# Autodesk Inventor assembly: MM0948AN100_G42_001
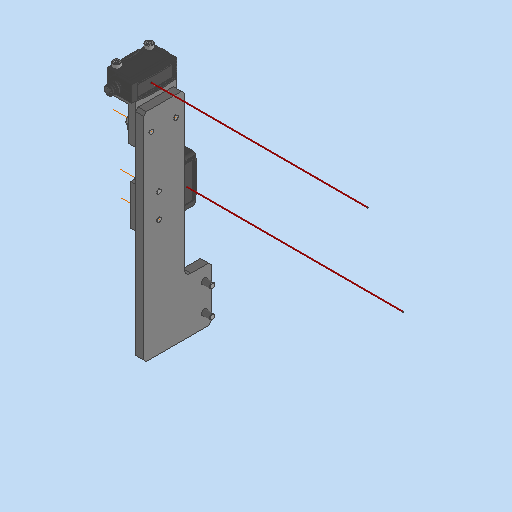
[picture p0: Inventor's stored thumbnail of the model, 512x512]
Saved by Autodesk Inventor 2023.3 (Build 273359000, 359)
## iProperties
Created: 2024-02-27
Part Number: MM0948AN100_G42_001
Description: =<RBPARTNOTITLE2>
Document SubType Name: Assembly
Designer: RIC7AN
Mass: 525.375 g
Surface Area: 330.007 cm^2
Volume: 64.7643 cm^3
Density: 8.11211 g/cm^3
RBPARTMADEOF: --
RBDRAWINGMISSINGSPEC: --
AnP_Kategorie: 99
RBPARTNOTITLE2: Sensorhalter
RBSURFACE: --
RBPARTNOTITLE1: sensor mount
AnP_Material: =<Material>
RBMATERIAL: =<Material>
RBMATNO: =<Part Number>
RBPARTNO: SIEHE MNR
Author: RIC7AN
Keywords: =<RBPARTMADEOF>
Comments: =<RBSURFACE2>
Revision Number: 01
## Documents named in this file (7)
- C:\Users\rea9an\Documents\Inventor\TCAI2412_te1910_EM\AS00000937.iam
- C:\Users\rea9an\Documents\Inventor\TCAI2412_te1910_EM\PT00004453.ipt
- C:\Users\rea9an\Documents\Inventor\TCAI2412_te1910_EM\PT00004626.ipt
- C:\Users\rea9an\Documents\Inventor\TCAI2412_te1910_EM\PT00004627.ipt
- C:\Users\rea9an\Documents\Inventor\TCAI2412_te1910_EM\PT00004867.ipt
- C:\Users\rea9an\Documents\Inventor\TCAI2412_te1910_EM\PT00004783.ipt
- C:\Users\rea9an\Documents\Inventor\TCAI2412_te1910_EM\PT00004859.ipt
## Components (19 placed, 6 different names)
1. PT00004453:1
2. PT00004626:1
3. PT00004627:1
4. PT00004627:2
5. PT00004453:2
6. PT00004867:1
7. PT00004783:1
8. PT00004867:2
9. PT00004783:2
10. PT00004867:3
11. PT00004783:3
12. PT00004867:4
13. PT00004783:4
14. PT00004867:5
15. PT00004867:6
16. PT00004859:1
17. PT00004859:2
18. PT00004859:3
19. PT00004859:4
## Relationships (30: Mate 18, Insert 9, Angle 2, Flush 1)
- [Mate]: PT00004626:1 ↔ PT00004627:1
- [Flush]: PT00004626:1 ↔ PT00004627:1
- [Mate]: PT00004453:1 ↔ PT00004627:1
- [Mate]: PT00004626:1 ↔ PT00004627:2
- [Mate]: PT00004453:1 ↔ PT00004627:1
- [Angle] (0 deg): PT00004453:1 ↔ PT00004627:1
- [Insert]: PT00004627:2 ↔ PT00004453:2
- [Angle] (0 deg): PT00004627:2 ↔ PT00004453:2
- [Mate]: PT00004626:1 ↔ PT00004627:2
- [Mate]: PT00004626:1 ↔ PT00004627:2
- [Insert]: PT00004867:1 ↔ PT00004783:1
- [Insert]: PT00004867:2 ↔ PT00004783:2
- [Insert]: PT00004867:3 ↔ PT00004783:3
- [Insert]: PT00004867:4 ↔ PT00004783:4
- [Mate]: PT00004627:1 ↔ PT00004867:1
- [Mate]: PT00004627:1 ↔ PT00004867:2
- [Mate]: PT00004627:2 ↔ PT00004867:3
- [Mate]: PT00004627:2 ↔ PT00004867:4
- [Mate]: PT00004627:1 ↔ PT00004783:1
- [Mate]: PT00004627:1 ↔ PT00004783:2
- [Mate]: PT00004627:2 ↔ PT00004783:3
- [Mate]: PT00004627:2 ↔ PT00004783:4
- [Insert]: PT00004626:1 ↔ PT00004867:5
- [Insert]: PT00004626:1 ↔ PT00004867:6
- [Insert]: PT00004453:1 ↔ PT00004859:4
- [Insert]: PT00004453:2 ↔ PT00004859:1
- [Mate]: PT00004627:1 ↔ PT00004859:2
- [Mate]: PT00004453:1 ↔ PT00004859:2
- [Mate]: PT00004627:2 ↔ PT00004859:3
- [Mate]: PT00004453:2 ↔ PT00004859:3
## Named parameters: d705_d704 = 0 mm, d706_d704 = 0 mm, d707_d704 = 0 mm
